# Autodesk Inventor assembly: robot
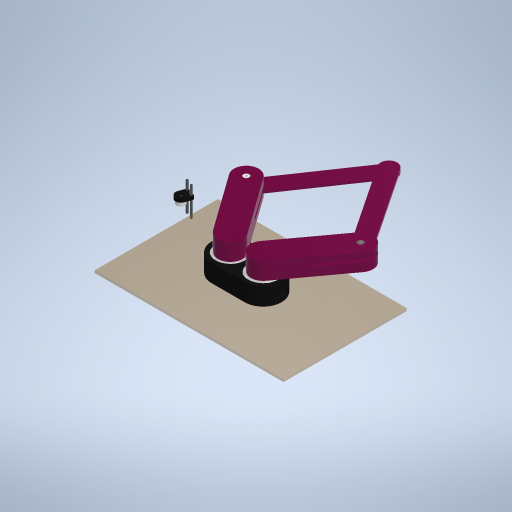
[picture p0: Inventor's stored thumbnail of the model, 512x512]
Saved by Autodesk Inventor 2024.2 (Build 282272000, 272)
## iProperties
Created: 2026-10-08
Part Number: robot
Document SubType Name: Assembly
Designer: User
Author: User
## Documents named in this file (13)
- D:\alletz2\ETZ_10\construction\робот\robot.iam
- D:\alletz2\ETZ_10\construction\робот\низ.ipt
- D:\alletz2\ETZ_10\construction\робот\GL60II\GL60II-3D\GL60II-3D.ipt
- D:\alletz2\ETZ_10\construction\робот\крепление мотора_часть 1.ipt
- D:\alletz2\ETZ_10\construction\робот\крепление мотора_втораядеталь_часть 1.ipt
- D:\alletz2\ETZ_10\construction\робот\крепление мотора_часть 2.ipt
- D:\alletz2\ETZ_10\construction\робот\плечо r1.ipt
- D:\alletz2\ETZ_10\construction\робот\плечо r2.ipt
- D:\alletz2\ETZ_10\construction\робот\подъемная часть.iam
- D:\alletz2\ETZ_10\construction\робот\подшипник большой.ipt
- D:\alletz2\ETZ_10\construction\робот\подшипник.ipt
- D:\alletz2\ETZ_10\construction\робот\проставка.ipt
- D:\alletz2\ETZ_10\construction\робот\проставка2побольше.ipt
## Components (21 placed, 12 different names)
1. низ:1 — Заподлицо:1, Совмещение:6, Заподлицо:4, Заподлицо:6, Заподлицо:7
2. крепление мотора_часть 1:1 — Заподлицо:1, Совмещение:5, Совмещение:7, Совмещение:8, Заподлицо:6, Заподлицо:8, С поворотом:6
3. GL60II-3D:1 — Совмещение:3, Совмещение:4, Совмещение:6, Заподлицо:4, Цилиндрический:15, Совмещение:17
4. GL60II-3D:2 — Совмещение:3, Совмещение:4, С поворотом:6, Цилиндрический:7, Совмещение:13
5. крепление мотора_втораядеталь_часть 1:1 — Совмещение:5, Совмещение:7, Совмещение:8, Заподлицо:7, Заподлицо:8
6. крепление мотора_часть 2:1
7. плечо r1:1 — Цилиндрический:1, Заподлицо:9, Цилиндрический:2, Совмещение:10, Цилиндрический:6, Совмещение:12, Цилиндрический:7, Совмещение:13, Цилиндрический:9, Заподлицо:12, Цилиндрический:11, Заподлицо:14
8. плечо r1:2 — Цилиндрический:3, Заподлицо:10, Цилиндрический:4, Заподлицо:11, Цилиндрический:10, Заподлицо:13, Цилиндрический:12, Заподлицо:15, Цилиндрический:14, Совмещение:16, Цилиндрический:15, Совмещение:17
9. плечо r2:1 — Цилиндрический:5, Совмещение:11, Цилиндрический:16
10. плечо r2:2 — Цилиндрический:8, Совмещение:14, Цилиндрический:16
11. подъемная часть:1 [sub-assembly]
12. подшипник большой:1 — Цилиндрический:8, Совмещение:14, Цилиндрический:14, Совмещение:16
13. подшипник:1 — Цилиндрический:2, Совмещение:10
14. проставка:1 — Цилиндрический:1, Заподлицо:9
15. подшипник большой:2 — Цилиндрический:5, Совмещение:11, Цилиндрический:6, Совмещение:12
16. подшипник:2 — Цилиндрический:4, Заподлицо:11
17. проставка:2 — Цилиндрический:3, Заподлицо:10
18. подшипник:3 — Цилиндрический:9, Заподлицо:12
19. подшипник:4 — Цилиндрический:10, Заподлицо:13
20. проставка2побольше:1 — Цилиндрический:12, Заподлицо:15
21. проставка2побольше:2 — Цилиндрический:11, Заподлицо:14
## Relationships (41: CylindricalJoint 15, Mate 13, Flush 12, RevoluteJoint 1)
- Заподлицо:1 [Flush]: низ:1 ↔ крепление мотора_часть 1:1
- Совмещение:3 [Mate]: GL60II-3D:1 ↔ GL60II-3D:2
- Совмещение:4 [Mate] (80 mm): GL60II-3D:1 ↔ GL60II-3D:2
- Совмещение:5 [Mate]: крепление мотора_часть 1:1 ↔ крепление мотора_втораядеталь_часть 1:1
- Совмещение:6 [Mate] (30 mm): низ:1 ↔ GL60II-3D:1
- Заподлицо:4 [Flush] (270 mm): низ:1 ↔ GL60II-3D:1
- Совмещение:7 [Mate]: крепление мотора_часть 1:1 ↔ крепление мотора_втораядеталь_часть 1:1
- Совмещение:8 [Mate]: крепление мотора_часть 1:1 ↔ крепление мотора_втораядеталь_часть 1:1
- Заподлицо:6 [Flush] (115 mm): низ:1 ↔ крепление мотора_часть 1:1
- Заподлицо:7 [Flush]: низ:1 ↔ крепление мотора_втораядеталь_часть 1:1
- Заподлицо:8 [Flush]: крепление мотора_часть 1:1 ↔ крепление мотора_втораядеталь_часть 1:1
- Цилиндрический:1 [CylindricalJoint]: плечо r1:1 ↔ проставка:1
- Заподлицо:9 [Flush]: плечо r1:1 ↔ проставка:1
- Цилиндрический:2 [CylindricalJoint]: плечо r1:1 ↔ подшипник:1
- Совмещение:10 [Mate]: плечо r1:1 ↔ подшипник:1
- Цилиндрический:3 [CylindricalJoint]: плечо r1:2 ↔ проставка:2
- Заподлицо:10 [Flush]: плечо r1:2 ↔ проставка:2
- Цилиндрический:4 [CylindricalJoint]: плечо r1:2 ↔ подшипник:2
- Заподлицо:11 [Flush]: плечо r1:2 ↔ подшипник:2
- Цилиндрический:5 [CylindricalJoint]: плечо r2:1 ↔ подшипник большой:2
- Совмещение:11 [Mate]: плечо r2:1 ↔ подшипник большой:2
- Цилиндрический:6 [CylindricalJoint]: плечо r1:1 ↔ подшипник большой:2
- Совмещение:12 [Mate]: плечо r1:1 ↔ подшипник большой:2
- С поворотом:6 [RevoluteJoint]: крепление мотора_часть 1:1 ↔ GL60II-3D:2
- Цилиндрический:7 [CylindricalJoint]: GL60II-3D:2 ↔ плечо r1:1
- Совмещение:13 [Mate]: GL60II-3D:2 ↔ плечо r1:1
- Цилиндрический:8 [CylindricalJoint]: плечо r2:2 ↔ подшипник большой:1
- Совмещение:14 [Mate]: плечо r2:2 ↔ подшипник большой:1
- Цилиндрический:9 [CylindricalJoint]: плечо r1:1 ↔ подшипник:3
- Заподлицо:12 [Flush]: плечо r1:1 ↔ подшипник:3
- Цилиндрический:10 [CylindricalJoint]: плечо r1:2 ↔ подшипник:4
- Заподлицо:13 [Flush]: плечо r1:2 ↔ подшипник:4
- Цилиндрический:11 [CylindricalJoint]: плечо r1:1 ↔ проставка2побольше:2
- Заподлицо:14 [Flush]: плечо r1:1 ↔ проставка2побольше:2
- Цилиндрический:12 [CylindricalJoint]: плечо r1:2 ↔ проставка2побольше:1
- Заподлицо:15 [Flush]: плечо r1:2 ↔ проставка2побольше:1
- Цилиндрический:14 [CylindricalJoint]: плечо r1:2 ↔ подшипник большой:1
- Совмещение:16 [Mate]: плечо r1:2 ↔ подшипник большой:1
- Цилиндрический:15 [CylindricalJoint]: GL60II-3D:1 ↔ плечо r1:2
- Совмещение:17 [Mate]: GL60II-3D:1 ↔ плечо r1:2
- Цилиндрический:16 [CylindricalJoint]: плечо r2:1 ↔ плечо r2:2
